# Autodesk Inventor assembly: Robotti_ilman_tarttujaa
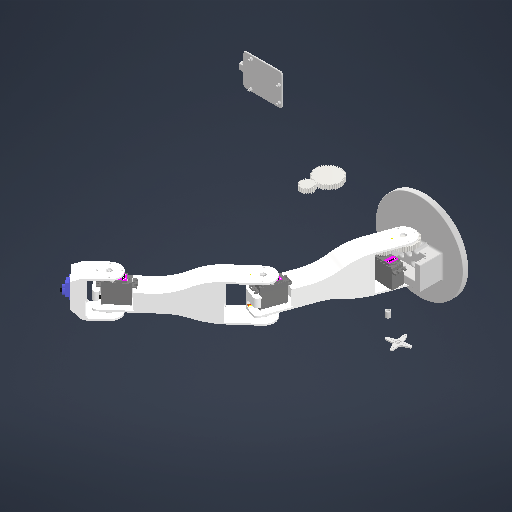
[picture p0: Inventor's stored thumbnail of the model, 512x512]
Saved by Autodesk Inventor 2027.1 (Build 311270010, 270A)
## iProperties
Created: 2025-11-26
Part Number: Robotti_ilman_tarttujaa
Document SubType Name: Assembly
Designer: kuuse
Author: kuuse
## Documents named in this file (11)
- C:\Users\nasra\Downloads\Arduino\KasiVarsi\.ipt .iam .step -tiedostot\Robotti_ilman_tarttujaa.iam
- C:\Users\nasra\Downloads\Arduino\KasiVarsi\.ipt .iam .step -tiedostot\mg996R_v2.ipt
- C:\Users\nasra\Downloads\Arduino\KasiVarsi\.ipt .iam .step -tiedostot\mg996_arm_4pad.ipt
- C:\Users\nasra\Downloads\Arduino\KasiVarsi\.ipt .iam .step -tiedostot\Jalusta_levy_new.ipt
- C:\Users\kuuse\Downloads\Jalusta_kehä (1).ipt
- C:\Users\nasra\Downloads\Arduino\KasiVarsi\.ipt .iam .step -tiedostot\arm1.ipt
- C:\Users\nasra\Downloads\Arduino\KasiVarsi\.ipt .iam .step -tiedostot\ranne.ipt
- C:\Users\nasra\Downloads\Arduino\KasiVarsi\.ipt .iam .step -tiedostot\Arm pin.ipt
- C:\Users\nasra\Downloads\Arduino\KasiVarsi\.ipt .iam .step -tiedostot\SG92R.ipt
- C:\Users\nasra\Downloads\Arduino\KasiVarsi\.ipt .iam .step -tiedostot\arduino_alusta.ipt
- C:\Users\nasra\Downloads\Arduino\KasiVarsi\.ipt .iam .step -tiedostot\Robotti_ilman_tarttujaa\Design Accelerator\Spur Gears4.iam
## Components (20 placed, 10 different names)
1. mg996R_v2:1 — Mate:17, Mate:18, Mate:19, Mate:20, Mate:21
2. mg996R_v2:2 — Rotational:3
3. mg996R_v2:3 — Mate:5, Mate:9, Mate:29, Mate:30, Mate:31
4. mg996R_v2:4 — Mate:7, Mate:11, Mate:34, Mate:35, Mate:36
5. mg996_arm_4pad:2
6. mg996_arm_4pad:3 — Mate:5, Mate:9, Mate:32, Mate:33
7. mg996_arm_4pad:4 — Mate:7, Mate:11, Mate:37, Mate:38
8. Jalusta_levy_new:1 — Mate:22, Mate:23, Flush:1, Rotational:1
9. Jalusta_kehä:1 — Mate:17, Mate:18, Mate:19, Mate:48, Mate:49
10. mg996_arm_4pad:5 — Mate:20, Mate:21, Mate:22, Mate:23
11. arm1:1 — Mate:29, Mate:30, Mate:31, Mate:43, Rotational:1, Rotational:2
12. arm1:2 — Mate:32, Mate:33, Mate:34, Mate:35, Mate:36, Mate:40, Mate:44
13. ranne:1 — Mate:37, Mate:38, Mate:39, Mate:45, Mate:46, Mate:47
14. Arm pin:1 — Mate:39, Mate:44
15. Arm pin:2 — Mate:40, Mate:43
16. Arm pin:3
17. SG92R:2 — Mate:45, Mate:46, Mate:47
18. arduino_alusta:1 — Mate:48, Mate:49
19. Spur Gears:1 [sub-assembly] — Rotational:2, Rotational:3
20. Spur Gears:2 [sub-assembly]
## Relationships (34: Mate 30, RevoluteJoint 3, Flush 1)
- Mate:5: mg996R_v2:3 ↔ mg996_arm_4pad:3
- Mate:7: mg996R_v2:4 ↔ mg996_arm_4pad:4
- Mate:9: mg996R_v2:3 ↔ mg996_arm_4pad:3
- Mate:11: mg996R_v2:4 ↔ mg996_arm_4pad:4
- Mate:17: mg996R_v2:1 ↔ Jalusta_kehä:1
- Mate:18: mg996R_v2:1 ↔ Jalusta_kehä:1
- Mate:19: mg996R_v2:1 ↔ Jalusta_kehä:1
- Mate:20: mg996R_v2:1 ↔ mg996_arm_4pad:5
- Mate:21: mg996R_v2:1 ↔ mg996_arm_4pad:5
- Mate:22: Jalusta_levy_new:1 ↔ mg996_arm_4pad:5
- Mate:23: Jalusta_levy_new:1 ↔ mg996_arm_4pad:5
- Mate:29: mg996R_v2:3 ↔ arm1:1
- Mate:30: mg996R_v2:3 ↔ arm1:1
- Mate:31: mg996R_v2:3 ↔ arm1:1
- Mate:32: mg996_arm_4pad:3 ↔ arm1:2
- Mate:33: mg996_arm_4pad:3 ↔ arm1:2
- Mate:34: mg996R_v2:4 ↔ arm1:2
- Mate:35: mg996R_v2:4 ↔ arm1:2
- Mate:36: mg996R_v2:4 ↔ arm1:2
- Mate:37: mg996_arm_4pad:4 ↔ ranne:1
- Mate:38: mg996_arm_4pad:4 ↔ ranne:1
- Mate:39: ranne:1 ↔ Arm pin:1
- Mate:40: arm1:2 ↔ Arm pin:2
- Mate:43: arm1:1 ↔ Arm pin:2
- Mate:44: arm1:2 ↔ Arm pin:1
- Mate:45: ranne:1 ↔ SG92R:2
- Mate:46: ranne:1 ↔ SG92R:2
- Mate:47: ranne:1 ↔ SG92R:2
- Mate:48: Jalusta_kehä:1 ↔ arduino_alusta:1
- Mate:49: Jalusta_kehä:1 ↔ arduino_alusta:1
- Flush:1: Jalusta_levy_new:1
- Rotational:1 [RevoluteJoint]: Jalusta_levy_new:1 ↔ arm1:1
- Rotational:2 [RevoluteJoint]: arm1:1 ↔ Spur Gears:1
- Rotational:3 [RevoluteJoint]: mg996R_v2:2 ↔ Spur Gears:1
